# Autodesk Inventor assembly: Assembly
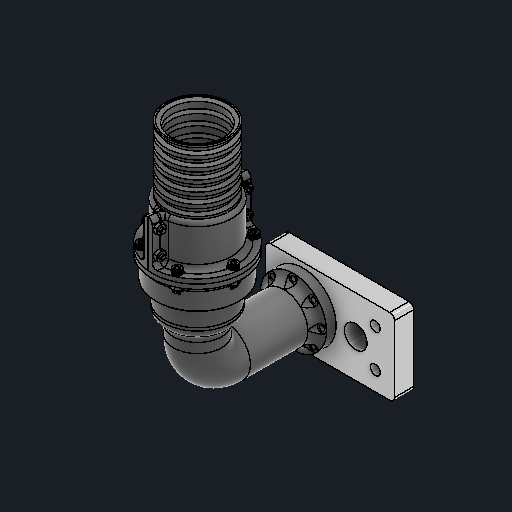
[picture p0: Inventor's stored thumbnail of the model, 512x512]
Saved by Autodesk Inventor 2026.2 (Build 302298000, 298)
## iProperties
Created: 2026-06-17
Part Number: Assembly
Document SubType Name: Assembly
Designer: JoshuaEah
Author: JoshuaEah
## Documents named in this file (5)
- C:\Users\Joshua Eah\Documents\GitHub\designs\Makera Carvera Air\Chip Control\Air Port Plate\Carvera Air Air Outlet Assembly.iam
- C:\Users\Joshua Eah\Documents\GitHub\designs\Makera Carvera Air\Chip Control\Air Port Plate\Air Port Plate.ipt
- C:\Users\Joshua Eah\Documents\GitHub\designs\Makera Carvera Air\Chip Control\Air Port Plate\Outlet Gasket.ipt
- C:\Users\Joshua Eah\Documents\GitHub\designs\Makera Carvera Air\Chip Control\Air Port Plate\Air Port Attachment.ipt
- C:\Users\Joshua Eah\Documents\GitHub\designs\40mm Vacuum Hose Attachment System\Assemblies\Nozzle Side Assembly.iam
## Components (4 placed, 4 different names)
1. Air Port Plate:1 — Insert:3, Insert:4, Insert:5
2. Outlet Gasket:1 — Insert:3
3. Air Port Attachment:1 — Insert:4, Insert:5, Mate:1, Mate:2
4. Nozzle Side Assembly:1 [sub-assembly] — Mate:1, Mate:2
## Relationships (5: Insert 3, Mate 2)
- Insert:3: Air Port Plate:1 ↔ Outlet Gasket:1
- Insert:4: Air Port Plate:1 ↔ Air Port Attachment:1
- Insert:5: Air Port Plate:1 ↔ Air Port Attachment:1
- Mate:1: Air Port Attachment:1 ↔ Nozzle Side Assembly:1
- Mate:2: Air Port Attachment:1 ↔ Nozzle Side Assembly:1
